# Autodesk Inventor assembly: CDJ2B10
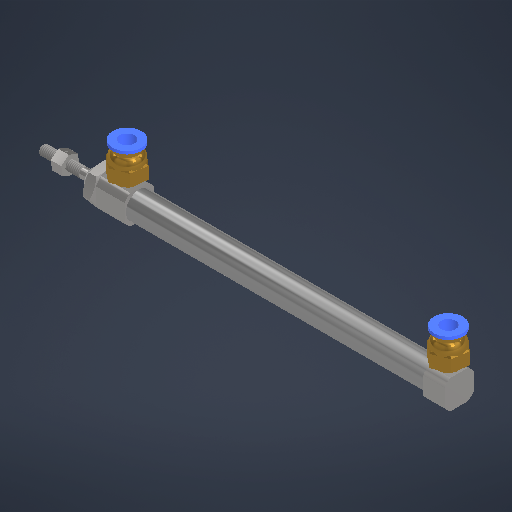
[picture p0: Inventor's stored thumbnail of the model, 512x512]
Saved by Autodesk Inventor 2026.2 (Build 302298010, 298A)
## iProperties
Created: 2026-05-08
Part Number: CDJ2B10
Document SubType Name: Assembly
Designer: work
Author: work
## Documents named in this file (6)
- C:\Users\work\Desktop\ARD_v1\ARD_hardware\Pneumatic fitting\CDJ2B10_100\CDJ2B10.iam
- C:\Users\work\Desktop\ARD_v1\ARD_hardware\Pneumatic fitting\CDJ2B10_100\Rod.ipt
- C:\Users\work\Desktop\ARD_v1\ARD_hardware\Pneumatic fitting\CDJ2B10_100\CDJ2B10_Body.ipt
- C:\Users\work\Desktop\ARD_v1\ARD_hardware\Pneumatic fitting\PC6-M5.ipt
- C:\Users\work\Desktop\ARD_v1\ARD_hardware\Pneumatic fitting\CDJ2B10_100\ANSI B18.2.4.5M - M8 x 1.25.ipt
- C:\Users\work\Desktop\ARD_v1\ARD_hardware\Pneumatic fitting\CDJ2B10_100\AS 1474 - M4(1).ipt
## Components (7 placed, 5 different names)
1. Rod:1 — 메이트:1, 플러쉬:1, 메이트:2, 메이트:3, 플러쉬:2
2. CDJ2B10_Body:1 — 메이트:1, 플러쉬:1, 회전:1, 회전:2, 회전:3, 메이트:5, 메이트:6, 각도:1
3. PC6-M5:1 — 회전:1
4. PC6-M5:2 — 회전:2
5. ANSI B18.2.4.5M - M8 x 1.25:1 — 회전:3
6. AS 1474 - M4(1):1 — 메이트:2, 메이트:4
7. AS 1474 - M4(1):2 — 메이트:3, 메이트:4, 플러쉬:2
## Relationships (12: Mate 6, RevoluteJoint 3, Flush 2, Angle 1)
- 메이트:1 [Mate]: Rod:1 ↔ CDJ2B10_Body:1
- 플러쉬:1 [Flush]: Rod:1 ↔ CDJ2B10_Body:1
- 회전:1 [RevoluteJoint]: CDJ2B10_Body:1 ↔ PC6-M5:1
- 회전:2 [RevoluteJoint]: CDJ2B10_Body:1 ↔ PC6-M5:2
- 회전:3 [RevoluteJoint]: CDJ2B10_Body:1 ↔ ANSI B18.2.4.5M - M8 x 1.25:1
- 메이트:2 [Mate]: Rod:1 ↔ AS 1474 - M4(1):1
- 메이트:3 [Mate]: Rod:1 ↔ AS 1474 - M4(1):2
- 메이트:4 [Mate]: AS 1474 - M4(1):1 ↔ AS 1474 - M4(1):2
- 플러쉬:2 [Flush] (7 mm): Rod:1 ↔ AS 1474 - M4(1):2
- 메이트:5 [Mate]: CDJ2B10_Body:1
- 메이트:6 [Mate]: CDJ2B10_Body:1
- 각도:1 [Angle] (0 deg): CDJ2B10_Body:1
